# Autodesk Inventor assembly: loft-angle
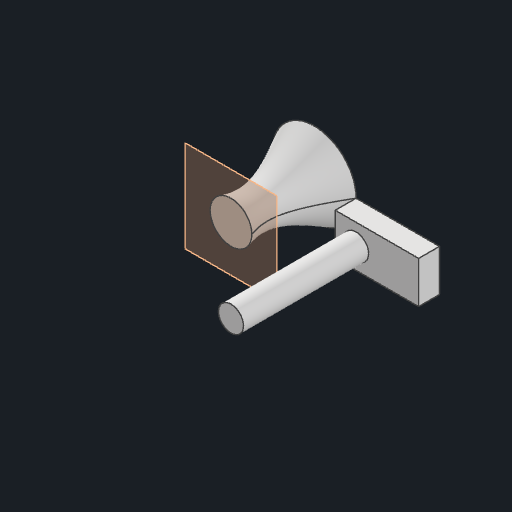
[picture p0: Inventor's stored thumbnail of the model, 512x512]
Saved by Autodesk Inventor 2026.1 (Build 301233000, 233)
## iProperties
Created: 2026-10-30
Part Number: loft-angle
Document SubType Name: Assembly
Designer: anony
Author: anony
## Documents named in this file (4)
- C:\Users\anony\OneDrive\Desktop\AI Projects\CAD Convert\corpus\generated\asmgrip\loft-angle.iam
- C:\Users\anony\OneDrive\Desktop\AI Projects\CAD Convert\corpus\generated\asmparts\box.ipt
- C:\Users\anony\OneDrive\Desktop\AI Projects\CAD Convert\corpus\generated\asmparts\pin.ipt
- C:\Users\anony\OneDrive\Desktop\AI Projects\CAD Convert\corpus\generated\loft\angle.ipt
## Components (3 placed, 3 different names)
1. box:1 — Mate:1, Mate:2, Tangent:1, Mate:3, Mate:4
2. pin:1 — Insert:1, Insert:2
3. angle:1 — Mate:1, Mate:2, Tangent:1, Insert:1, Insert:2, Mate:3, Mate:4
## Relationships (7: Mate 4, Insert 2, Tangent 1)
- Mate:1: box:1 ↔ angle:1
- Mate:2: box:1 ↔ angle:1
- Tangent:1: box:1 ↔ angle:1
- Insert:1: pin:1 ↔ angle:1
- Insert:2: pin:1 ↔ angle:1
- Mate:3: box:1 ↔ angle:1
- Mate:4: box:1 ↔ angle:1
